# Autodesk Inventor assembly: RDS-6000 ladder Frame
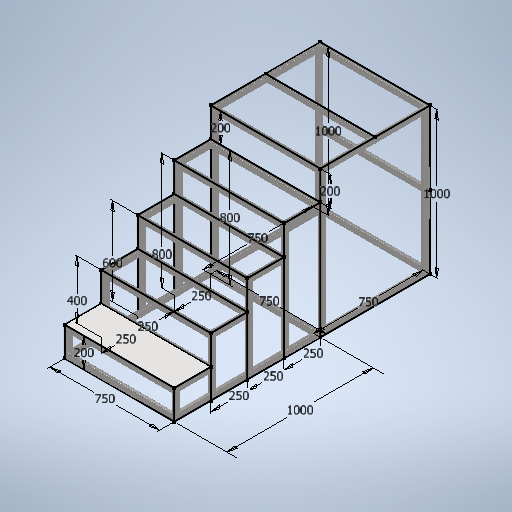
[picture p0: Inventor's stored thumbnail of the model, 512x512]
Saved by Autodesk Inventor 2026 (Build 300175000, 175)
## iProperties
_SolveAssemblyDoc: Frame Generator Solve Assembly
_Version: 15.0.0
Created: 2026-10-14
Part Number: RDS-6000 ladder Frame
Document SubType Name: Assembly
Designer: user
Mass: 45356.6 g
Surface Area: 60823 cm^2
Volume: 6432.36 cm^3
Density: 7.0513 g/cm^3
Author: user
## Documents named in this file (4)
- C:\Users\user\Documents\Inventor\RDS-Reagent-Dosing-Station\RDS-6000 ladder Frame.iam
- C:\Users\user\Documents\Inventor\RDS-Reagent-Dosing-Station\RDS-6000 ladder.ipt
- C:\Users\user\Documents\Inventor\RDS-Reagent-Dosing-Station\RDS-6000 ladder Frame\Frame\Frame 1791984824670.iam
- C:\Users\user\Documents\Inventor\RDS-Reagent-Dosing-Station\RDS-6000 ladder Frame\RDS-3003 Deck 750x250.ipt
## Components (3 placed, 3 different names)
1. RDS-6000 ladder:1
2. Frame 1791984824670:1 [sub-assembly] — Совмещение:1, Заподлицо:1, Заподлицо:2
3. RDS-3003 Deck 750x250:1 — Совмещение:1, Заподлицо:1, Заподлицо:2
## Relationships (3: Flush 2, Mate 1)
- Совмещение:1 [Mate]: Frame 1791984824670:1 ↔ RDS-3003 Deck 750x250:1
- Заподлицо:1 [Flush]: Frame 1791984824670:1 ↔ RDS-3003 Deck 750x250:1
- Заподлицо:2 [Flush]: Frame 1791984824670:1 ↔ RDS-3003 Deck 750x250:1
